# Autodesk Inventor assembly: MM0861AN200_G24_803
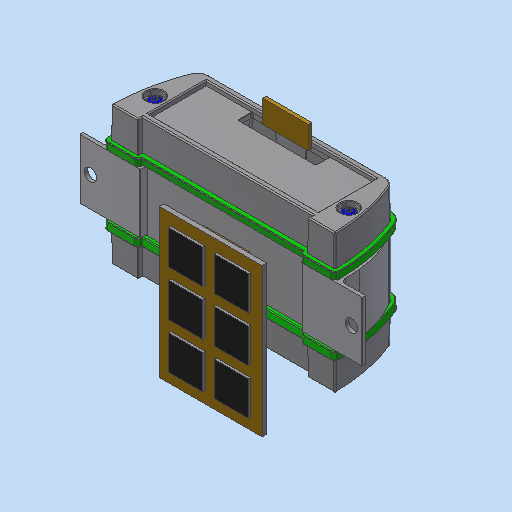
[picture p0: Inventor's stored thumbnail of the model, 512x512]
Saved by Autodesk Inventor 2023.3 (Build 273359000, 359)
## iProperties
Part Number: MM0861AN200_G24_803
Material: Generisch
Description: =<RBPARTNOTITLE2>
Document SubType Name: Assembly
Designer: Benutzer
Vendor: TEF2
RBCHANGEDESCRIPTION1: Erstfreigabe
RBCHANGENO1: 00
RBDOCUMENTTYPE: DRF
RBDOCUMENTVERSION: 00
RBDRAWINGMAINSCALE: 1:1
RBDRAWINGMISSINGSPEC: --
RBDRAWINGVOLUME: --
RBDSV1: 0850
RBGBDETAILS: 43274
RBGBEDGESIN1: +0,5
RBGBEDGESIN2: +0,2
RBGBEDGESOUT1: -0,3
RBGBEDGESOUT2: -0,1
RBMATERIAL: --
RBMATMEETS: --
RBMATNO: =<Part Number>
RBORGUNITRESPONSIBLE1: AnP/TEF1
RBPARTMADEOF: --
RBPARTNO: SIEHE MNR
RBPARTNOTITLE1: TEF operation panel
RBPARTNOTITLE2: TEF Bedienpanel
RBPARTSAFETYINDICATOR: --
RBSURFACE: --
RBSURFACE2: --
RBZEDGESNORM: ISO13715:2002-06
RBZGENDIMCLASS: m
RBZGENDIMNORM: ISO 2768-1:1989-11
RBZGENGEOCLASS: H
RBZGENGEONORM: ISO 2768-2:1989-11
RBZSURFACENORM: ISO13D2:2002-02
RBZTOLERANCENORM: ISO 14405-1:2010-12
AnP_Kommentar: --
MaxAbmaße: --
AnP_TemplVers: 20190222
AnP_Kategorie: 11
AnP_Material: =<Material>
RBGBREMARKSINDEX: E
AnP_Standard: 3
Author: Benutzer
Keywords: =<RBPARTMADEOF>
Comments: =<RBSURFACE2>
Revision Number: 01
## Documents named in this file (3)
- C:\Users\rea9an\Documents\Inventor\TCAI2412_te1910_EM\AS00000901.iam
- C:\Users\rea9an\Documents\Inventor\TCAI2412_te1910_EM\PT00004816.ipt
- C:\Users\rea9an\Documents\Inventor\TCAI2412_te1910_EM\PT00004815.ipt
## Components (2 placed, 2 different names)
1. PT00004815:2 — Passend:1, Fluchtend:3, Fluchtend:4, Passend:6
2. PT00004816:1 — Passend:1, Fluchtend:3, Fluchtend:4, Passend:6
## Relationships (4: Mate 2, Flush 2)
- Passend:1 [Mate] (2 mm): PT00004815:2 ↔ PT00004816:1
- Fluchtend:3 [Flush]: PT00004815:2 ↔ PT00004816:1
- Fluchtend:4 [Flush] (-23 mm): PT00004815:2 ↔ PT00004816:1
- Passend:6 [Mate]: PT00004815:2 ↔ PT00004816:1
